# Autodesk Inventor assembly: AssemblyRDR
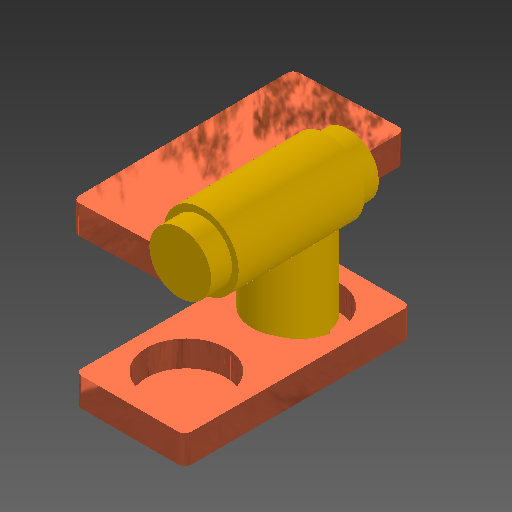
[picture p0: Inventor's stored thumbnail of the model, 512x512]
Saved by Autodesk Inventor 2026.1 (Build 301233020, 233B)
## iProperties
Created: 2026-10-19
Part Number: AssemblyRDR
Document SubType Name: Assembly
Designer: YmCris
Author: YmCris
## Documents named in this file (3)
- C:\Users\Fortune\Mechanical Engenieering\Fourth Semester\Mechanical Engineering Drawing\Inventor Projects\Classes\Assambling\Worksheet19-10-2026\AssemblyRDR.iam
- C:\Users\Fortune\Mechanical Engenieering\Fourth Semester\Mechanical Engineering Drawing\Inventor Projects\Classes\Assambling\Worksheet19-10-2026\Base para cojinetesipt.ipt
- C:\Users\Fortune\Mechanical Engenieering\Fourth Semester\Mechanical Engineering Drawing\Inventor Projects\Classes\Assambling\Worksheet19-10-2026\Eje de cojinetes.ipt
## Components (4 placed, 2 different names)
1. Base para cojinetesipt:1
2. Eje de cojinetes:1 — Mate:1
3. Eje de cojinetes:2
4. Base para cojinetesipt:2 — Mate:1
## Relationships (1: Mate 1)
- Mate:1: Eje de cojinetes:1 ↔ Base para cojinetesipt:2
